# Autodesk Inventor assembly: Assembly1
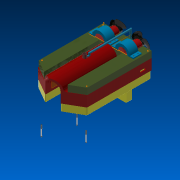
[picture p0: Inventor's stored thumbnail of the model, 180x180]
Saved by Autodesk Inventor 2019 (Build 230136000, 136)
## iProperties
Created: 2019-03-26
Part Number: Assembly1
Document SubType Name: Assembly
Designer: --------
Author: --------
## Documents named in this file (14)
- G:\ASU\Sem8\Design of mecha\Pcleaner V3\PCleanerV3\Assembly1.iam
- G:\ASU\Sem8\Design of mecha\Pcleaner V3\PCleanerV3\Chassis.ipt
- G:\ASU\Sem8\Design of mecha\Pcleaner V3\PCleanerV3\new base.ipt
- G:\ASU\Sem8\Design of mecha\Pcleaner V3\PCleanerV3\prop.ipt
- G:\ASU\Sem8\Design of mecha\Pcleaner V3\PCleanerV3\floating bed.ipt
- G:\ASU\Sem8\Design of mecha\Pcleaner V3\PCleanerV3\Bilge-pump.ipt
- G:\ASU\Sem8\Design of mecha\Pcleaner V3\PCleanerV3\aquarium pump head.ipt
- G:\ASU\Sem8\Design of mecha\Pcleaner V3\PCleanerV3\Pump Holder.ipt
- G:\ASU\Sem8\Design of mecha\Pcleaner V3\PCleanerV3\pump filter.ipt
- G:\ASU\Sem8\Design of mecha\Pcleaner V3\PCleanerV3\air pump tube.ipt
- G:\ASU\Sem8\Design of mecha\Pcleaner V3\PCleanerV3\Bilge Pump Holder.ipt
- G:\ASU\Sem8\Design of mecha\Pcleaner V3\PCleanerV3\CSN 02 1174 - B M5 x 45.ipt
- G:\ASU\Sem8\Design of mecha\Pcleaner V3\PCleanerV3\Button.ipt
- G:\ASU\Sem8\Design of mecha\Pcleaner V3\PCleanerV3\5mm LED.ipt
## Components (30 placed, 13 different names)
1. Chassis:1 — Flush:1, Flush:2, Mate:1, Mate:34, Mate:35, Mate:36
2. new base:1 — Flush:1, Flush:2, Mate:1, Mate:2, Flush:3, Flush:4, Mate:11, Mate:12, Mate:13, Angle:1, Mate:28, Mate:29, Mate:30, Mate:31, Mate:32, Mate:33
3. prop:1 — Mate:9, Mate:10, Rotation:2
4. prop:2 — Rotation:1, Mate:19, Mate:20
5. floating bed:1 — Mate:2, Flush:3, Flush:4, Mate:17, Mate:18, Mate:21, Mate:22, Mate:24, Mate:25, Mate:26, Mate:27, Mate:37, Mate:38, Mate:39, Mate:41, Mate:42, Mate:43, Mate:44
6. Bilge-pump:1 — Rotation:1, Mate:19, Mate:20, Mate:21, Mate:22
7. Bilge-pump:2 — Mate:9, Mate:10, Rotation:2, Mate:17, Mate:18, Mate:23
8. aquarium pump head:1 — Mate:11, Mate:12, Flush:5, Mate:14, Mate:15, Mate:16
9. Pump Holder:1 — Mate:13, Flush:5, Mate:14
10. pump filter:1 — Mate:15
11. air pump tube:1 — Mate:16, Angle:1
12. Bilge Pump Holder:1 — Mate:23, Mate:24, Mate:25
13. Bilge Pump Holder:2 — Mate:26, Mate:27, Mate:40
14. CSN 02 1174 B B M5 x 45:1 — Mate:33
15. CSN 02 1174 B B M5 x 45:3 — Mate:31
16. CSN 02 1174 B B M5 x 45:4 — Mate:30
17. CSN 02 1174 B B M5 x 45:5 — Mate:29
18. CSN 02 1174 B B M5 x 45:6 — Mate:32
19. CSN 02 1174 B B M5 x 45:7 — Mate:28
20. Button:1 — Mate:34
21. 5mm LED:1 — Mate:36
22. 5mm LED:2 — Mate:35
23. CSN 02 1174 B B M5 x 45:8 — Mate:41
24. CSN 02 1174 B B M5 x 45:9 — Mate:39
25. CSN 02 1174 B B M5 x 45:10 — Mate:43
26. CSN 02 1174 B B M5 x 45:11 — Mate:44
27. CSN 02 1174 B B M5 x 45:12 — Mate:42
28. CSN 02 1174 B B M5 x 45:13 — Mate:38
29. CSN 02 1174 B B M5 x 45:14 — Mate:40
30. CSN 02 1174 B B M5 x 45:15 — Mate:37
## Relationships (46: Mate 38, Flush 5, RelateRotation 2, Angle 1)
- Flush:1: Chassis:1 ↔ new base:1
- Flush:2: Chassis:1 ↔ new base:1
- Mate:1: Chassis:1 ↔ new base:1
- Mate:2: new base:1 ↔ floating bed:1
- Flush:3: new base:1 ↔ floating bed:1
- Flush:4: new base:1 ↔ floating bed:1
- Mate:9: prop:1 ↔ Bilge-pump:2
- Mate:10 (2 mm): prop:1 ↔ Bilge-pump:2
- Rotation:1 [RelateRotation] (1 ul): prop:2 ↔ Bilge-pump:1
- Rotation:2 [RelateRotation] (1 ul): prop:1 ↔ Bilge-pump:2
- Mate:11: new base:1 ↔ aquarium pump head:1
- Mate:12: new base:1 ↔ aquarium pump head:1
- Mate:13: new base:1 ↔ Pump Holder:1
- Flush:5: aquarium pump head:1 ↔ Pump Holder:1
- Mate:14: aquarium pump head:1 ↔ Pump Holder:1
- Mate:15: aquarium pump head:1 ↔ pump filter:1
- Mate:16: aquarium pump head:1 ↔ air pump tube:1
- Angle:1 (0 deg): new base:1 ↔ air pump tube:1
- Mate:17: floating bed:1 ↔ Bilge-pump:2
- Mate:18: floating bed:1 ↔ Bilge-pump:2
- Mate:19: prop:2 ↔ Bilge-pump:1
- Mate:20 (2 mm): prop:2 ↔ Bilge-pump:1
- Mate:21: floating bed:1 ↔ Bilge-pump:1
- Mate:22: floating bed:1 ↔ Bilge-pump:1
- Mate:23: Bilge-pump:2 ↔ Bilge Pump Holder:1
- Mate:24: floating bed:1 ↔ Bilge Pump Holder:1
- Mate:25: floating bed:1 ↔ Bilge Pump Holder:1
- Mate:26: floating bed:1 ↔ Bilge Pump Holder:2
- Mate:27: floating bed:1 ↔ Bilge Pump Holder:2
- Mate:28: new base:1 ↔ CSN 02 1174 B B M5 x 45:7
- Mate:29: new base:1 ↔ CSN 02 1174 B B M5 x 45:5
- Mate:30: new base:1 ↔ CSN 02 1174 B B M5 x 45:4
- Mate:31: new base:1 ↔ CSN 02 1174 B B M5 x 45:3
- Mate:32: new base:1 ↔ CSN 02 1174 B B M5 x 45:6
- Mate:33: new base:1 ↔ CSN 02 1174 B B M5 x 45:1
- Mate:34: Chassis:1 ↔ Button:1
- Mate:35: Chassis:1 ↔ 5mm LED:2
- Mate:36: Chassis:1 ↔ 5mm LED:1
- Mate:37: floating bed:1 ↔ CSN 02 1174 B B M5 x 45:15
- Mate:38: floating bed:1 ↔ CSN 02 1174 B B M5 x 45:13
- Mate:39: floating bed:1 ↔ CSN 02 1174 B B M5 x 45:9
- Mate:40: Bilge Pump Holder:2 ↔ CSN 02 1174 B B M5 x 45:14
- Mate:41: floating bed:1 ↔ CSN 02 1174 B B M5 x 45:8
- Mate:42: floating bed:1 ↔ CSN 02 1174 B B M5 x 45:12
- Mate:43: floating bed:1 ↔ CSN 02 1174 B B M5 x 45:10
- Mate:44: floating bed:1 ↔ CSN 02 1174 B B M5 x 45:11
